# Autodesk Inventor assembly: revolve-full
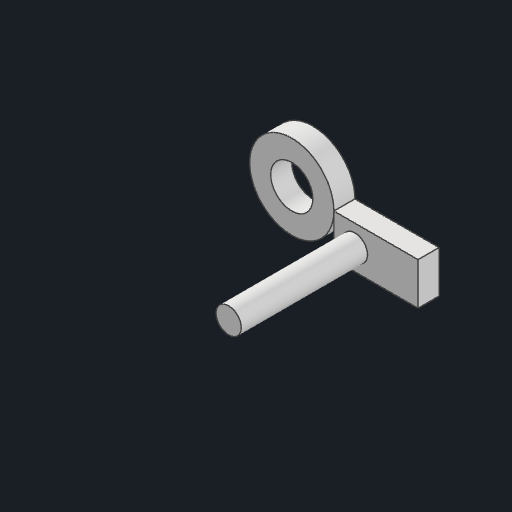
[picture p0: Inventor's stored thumbnail of the model, 512x512]
Saved by Autodesk Inventor 2026.1 (Build 301233000, 233)
## iProperties
Created: 2026-10-30
Part Number: revolve-full
Document SubType Name: Assembly
Designer: david
Author: anony
## Documents named in this file (4)
- C:\Users\anony\OneDrive\Desktop\AI Projects\CAD Convert\corpus\generated\asmgrip\revolve-full.iam
- C:\Users\anony\OneDrive\Desktop\AI Projects\CAD Convert\corpus\generated\asmparts\box.ipt
- C:\Users\anony\OneDrive\Desktop\AI Projects\CAD Convert\corpus\generated\asmparts\pin.ipt
- C:\Users\anony\OneDrive\Desktop\AI Projects\CAD Convert\corpus\generated\revolve\full.ipt
## Components (3 placed, 3 different names)
1. box:1 — Mate:2, Mate:4, Mate:5, Mate:6, Mate:7, Mate:8
2. pin:1 — Mate:1, Mate:3, Insert:1, Insert:2, Insert:3, Insert:4
3. full:1 — Mate:1, Mate:2, Mate:3, Mate:4, Insert:1, Insert:2, Insert:3, Insert:4, Mate:5, Mate:6, Mate:7, Mate:8
## Relationships (12: Mate 8, Insert 4)
- Mate:1: pin:1 ↔ full:1
- Mate:2: box:1 ↔ full:1
- Mate:3: pin:1 ↔ full:1
- Mate:4: box:1 ↔ full:1
- Insert:1: pin:1 ↔ full:1
- Insert:2: pin:1 ↔ full:1
- Insert:3: pin:1 ↔ full:1
- Insert:4: pin:1 ↔ full:1
- Mate:5: box:1 ↔ full:1
- Mate:6: box:1 ↔ full:1
- Mate:7: box:1 ↔ full:1
- Mate:8: box:1 ↔ full:1
